# Autodesk Inventor assembly: ASSEMBLY_DUT_Ant_Rotator_REVB
(part 5 of 5)
- Mate:871: LC_3mm_ALU_Alu_Frame_Brace_REVB:1 ↔ DIN 125-1 A A 4,3:26
- Mate:872: LC_3mm_ALU_Alu_Frame_Brace_REVB:1 ↔ DIN 125-1 A A 4,3:26
- Insert:48: DIN 125-1 A A 4,3:25 ↔ DIN 912 - replaced by DIN EN ISO 4762 M4 x 25:1
- Insert:49: DIN 125-1 A A 4,3:26 ↔ DIN 912 - replaced by DIN EN ISO 4762 M4 x 25:2
- Mate:873: LC_3mm_ALU_Alu_Frame_Brace_REVB:1 ↔ DIN 934 - replaced by DIN EN 24032/28673/28674 M4:33
- Mate:874: 3DP_PLA_Alu_Frame_Brace_REVB:1 ↔ DIN 934 - replaced by DIN EN 24032/28673/28674 M4:33
- Mate:875: LC_3mm_ALU_Alu_Frame_Brace_REVB:1 ↔ DIN 934 - replaced by DIN EN 24032/28673/28674 M4:34
- Mate:876: 3DP_PLA_Alu_Frame_Brace_REVB:1 ↔ DIN 934 - replaced by DIN EN 24032/28673/28674 M4:34
- Mate:877: COTS_Fleximo_FB12020_20x20_Alu_Profile_600mm:1 ↔ 3DP_PLA_Folded_Leg_Holder_REVB:1
- Flush:48 (-2.5 mm): COTS_Fleximo_FB12020_20x20_Alu_Profile_600mm:1 ↔ 3DP_PLA_Folded_Leg_Holder_REVB:1
- Flush:49 (80 mm): COTS_Fleximo_FB12020_20x20_Alu_Profile_150mm:1 ↔ 3DP_PLA_Folded_Leg_Holder_REVB:1
- Mate:878: 3DP_PLA_Folded_Leg_Holder_REVB:1 ↔ DIN 912 - replaced by DIN EN ISO 4762 M4 x 16:7
- Mate:879: 3DP_PLA_Folded_Leg_Holder_REVB:1 ↔ DIN 912 - replaced by DIN EN ISO 4762 M4 x 16:7
- Mate:880: 3DP_PLA_Carbon_Rod_Holder_Bottom_REVB:1 ↔ COTS_Fleximo_FB12020_20x20_Alu_Profile_150mm:5
- Flush:50: 3DP_PLA_Carbon_Rod_Holder_Bottom_REVB:1 ↔ COTS_Fleximo_FB12020_20x20_Alu_Profile_150mm:5
- Flush:51: 3DP_PLA_Carbon_Rod_Holder_Bottom_REVB:1 ↔ COTS_Fleximo_FB12020_20x20_Alu_Profile_600mm:3
- Mate:881: 3DP_PLA_Carbon_Rod_Holder_Top_REVB:1 ↔ COTS_Fleximo_FB12020_20x20_Alu_Profile_150mm:6
- Flush:52: 3DP_PLA_Carbon_Rod_Holder_Top_REVB:1 ↔ COTS_Fleximo_FB12020_20x20_Alu_Profile_150mm:6
- Flush:53: 3DP_PLA_Carbon_Rod_Holder_Top_REVB:1 ↔ COTS_Fleximo_FB12020_20x20_Alu_Profile_600mm:3
- Mate:882: 3DP_PLA_Carbon_Rod_Holder_Top_REVB:1 ↔ DIN 125-1 A A 4,3:39
- Mate:883: 3DP_PLA_Carbon_Rod_Holder_Top_REVB:1 ↔ DIN 125-1 A A 4,3:39
- Mate:884: 3DP_PLA_Carbon_Rod_Holder_Top_REVB:1 ↔ DIN 125-1 A A 4,3:40
- Mate:885: 3DP_PLA_Carbon_Rod_Holder_Top_REVB:1 ↔ DIN 125-1 A A 4,3:40
- Mate:886: 3DP_PLA_Carbon_Rod_Holder_Bottom_REVB:1 ↔ DIN 125-1 A A 4,3:41
- Mate:887: 3DP_PLA_Carbon_Rod_Holder_Top_REVB:1 ↔ DIN 125-1 A A 4,3:41
- Mate:888: 3DP_PLA_Carbon_Rod_Holder_Bottom_REVB:1 ↔ DIN 125-1 A A 4,3:42
- Mate:889: 3DP_PLA_Carbon_Rod_Holder_Top_REVB:1 ↔ DIN 125-1 A A 4,3:42
- Insert:50: DIN 912 - replaced by DIN EN ISO 4762 M4 x 10:20 ↔ DIN 125-1 A A 4,3:39
- Insert:51: DIN 912 - replaced by DIN EN ISO 4762 M4 x 10:21 ↔ DIN 125-1 A A 4,3:40
- Insert:52: DIN 912 - replaced by DIN EN ISO 4762 M4 x 10:22 ↔ DIN 125-1 A A 4,3:41
- Insert:53: DIN 912 - replaced by DIN EN ISO 4762 M4 x 10:23 ↔ DIN 125-1 A A 4,3:42
- Mate:890: COTS_Fleximo_FB12020_20x20_Alu_Profile_600mm:1 ↔ 3DP_PLA_Frame_Stiffener_and_Leg_REVB:1
- Flush:54: COTS_Fleximo_FB12020_20x20_Alu_Profile_600mm:1 ↔ 3DP_PLA_Frame_Stiffener_and_Leg_REVB:1
- Flush:55: COTS_Fleximo_FB12020_20x20_Alu_Profile_600mm:1 ↔ 3DP_PLA_Frame_Stiffener_and_Leg_REVB:1
- Mate:891: ISO 7380-1 M6 x 16:1 ↔ 3DP_PLA_Frame_Stiffener_and_Leg_REVB:1
- Mate:892: ISO 7380-1 M6 x 16:1 ↔ 3DP_PLA_Frame_Stiffener_and_Leg_REVB:1
- Mate:893: 3DP_PLA_Frame_Stiffener_and_Leg_REVB:1 ↔ ISO 7380-1 M5 x 8:1
- Mate:894: 3DP_PLA_Frame_Stiffener_and_Leg_REVB:1 ↔ ISO 7380-1 M5 x 8:1
- Mate:895: 3DP_PLA_Frame_Stiffener_and_Leg_REVB:1 ↔ ISO 7380-1 M5 x 8:2
- Mate:896: 3DP_PLA_Frame_Stiffener_and_Leg_REVB:1 ↔ ISO 7380-1 M5 x 8:2
- Mate:897: COTS_Fleximo_FB12020_20x20_Alu_Profile_600mm:1 ↔ 3DP_PLA_Frame_Stiffener_and_Leg_REVB:2
- Flush:56: COTS_Fleximo_FB12020_20x20_Alu_Profile_600mm:1 ↔ 3DP_PLA_Frame_Stiffener_and_Leg_REVB:2
- Flush:57: COTS_Fleximo_FB12020_20x20_Alu_Profile_600mm:1 ↔ 3DP_PLA_Frame_Stiffener_and_Leg_REVB:2
- Mate:898: 3DP_PLA_Frame_Stiffener_and_Leg_REVB:2 ↔ ISO 7380-1 M6 x 16:2
- Mate:899: 3DP_PLA_Frame_Stiffener_and_Leg_REVB:2 ↔ ISO 7380-1 M6 x 16:2
- Mate:900: 3DP_PLA_Frame_Stiffener_and_Leg_REVB:2 ↔ ISO 7380-1 M5 x 8:3
- Mate:901: 3DP_PLA_Frame_Stiffener_and_Leg_REVB:2 ↔ ISO 7380-1 M5 x 8:3
- Mate:902: 3DP_PLA_Frame_Stiffener_and_Leg_REVB:2 ↔ ISO 7380-1 M5 x 8:4
- Mate:903: 3DP_PLA_Frame_Stiffener_and_Leg_REVB:2 ↔ ISO 7380-1 M5 x 8:4
- Mate:904: COTS_Fleximo_FB12020_20x20_Alu_Profile_575mm:1 ↔ 3DP_PLA_Frame_Leg_Leg_REVB:1
- Flush:58: COTS_Fleximo_FB12020_20x20_Alu_Profile_575mm:1 ↔ 3DP_PLA_Frame_Leg_Leg_REVB:1
- Flush:59: 3DP_PLA_Foldable_Leg_Brace_Mount_REVB:1 ↔ 3DP_PLA_Frame_Leg_Leg_REVB:1
- Mate:905: ISO 7380-1 M5 x 8:13 ↔ 3DP_PLA_Frame_Leg_Leg_REVB:1
- Mate:906: ISO 7380-1 M5 x 8:13 ↔ 3DP_PLA_Frame_Leg_Leg_REVB:1
- Mate:907: 3DP_PLA_Frame_Leg_Leg_REVB:1 ↔ ISO 7380-1 M5 x 8:14
- Mate:908: 3DP_PLA_Frame_Leg_Leg_REVB:1 ↔ ISO 7380-1 M5 x 8:14
- Mate:909: 3DP_PLA_Electronics_Box_Bottom_REVB:1 ↔ ASSEMBLY_PCB_SERVO_CONN:1
- Mate:910: 3DP_PLA_Electronics_Box_Bottom_REVB:1 ↔ ASSEMBLY_PCB_SERVO_CONN:1
- Mate:911: 3DP_PLA_Electronics_Box_Bottom_REVB:1 ↔ ASSEMBLY_PCB_SERVO_CONN:1
- Mate:912: 3DP_PLA_Electronics_Box_Bottom_REVB:1 ↔ COTS_MKS_Canable_2_0:1
- Mate:913: 3DP_PLA_Electronics_Box_Bottom_REVB:1 ↔ COTS_MKS_Canable_2_0:1
- Mate:914: 3DP_PLA_Electronics_Box_Bottom_REVB:1 ↔ COTS_MKS_Canable_2_0:1
- Mate:915: 3DP_PLA_Electronics_Box_Bottom_REVB:1 ↔ COTS_Fleximo_FB12020_20x20_Alu_Profile_600mm:2
- Mate:916: 3DP_PLA_Electronics_Box_Bottom_REVB:1 ↔ COTS_Fleximo_FB12020_20x20_Alu_Profile_600mm:2
- Flush:60: 3DP_PLA_Electronics_Box_Bottom_REVB:1 ↔ 3DP_PLA_Folded_Leg_Holder_REVB:3
- Mate:917: 3DP_PLA_Electronics_Box_Bottom_REVB:1 ↔ 3DP_PLA_Electronics_Box_Top_REVB:1
- Flush:61: 3DP_PLA_Electronics_Box_Bottom_REVB:1 ↔ 3DP_PLA_Electronics_Box_Top_REVB:1
- Flush:62: 3DP_PLA_Electronics_Box_Bottom_REVB:1 ↔ 3DP_PLA_Electronics_Box_Top_REVB:1
- Mate:918: ASSEMBLY_PCB_SERVO_CONN:1 ↔ ISO 7380-1 M3 x 6:1
- Mate:919: ASSEMBLY_PCB_SERVO_CONN:1 ↔ ISO 7380-1 M3 x 6:1
- Mate:920: ASSEMBLY_PCB_SERVO_CONN:1 ↔ ISO 7380-1 M3 x 6:2
- Mate:921: ASSEMBLY_PCB_SERVO_CONN:1 ↔ ISO 7380-1 M3 x 6:2
- Mate:922: ASSEMBLY_PCB_SERVO_CONN:1 ↔ ISO 7380-1 M3 x 6:3
- Mate:923: ASSEMBLY_PCB_SERVO_CONN:1 ↔ ISO 7380-1 M3 x 6:3
- Mate:924: ASSEMBLY_PCB_SERVO_CONN:1 ↔ ISO 7380-1 M3 x 6:4
- Mate:925: ASSEMBLY_PCB_SERVO_CONN:1 ↔ ISO 7380-1 M3 x 6:4
- Mate:926: COTS_MKS_Canable_2_0:1 ↔ DIN 912 - replaced by DIN EN ISO 4762 M2 x 6:1
- Mate:927: COTS_MKS_Canable_2_0:1 ↔ DIN 912 - replaced by DIN EN ISO 4762 M2 x 6:1
- Mate:928: COTS_MKS_Canable_2_0:1 ↔ DIN 912 - replaced by DIN EN ISO 4762 M2 x 6:2
- Mate:929: COTS_MKS_Canable_2_0:1 ↔ DIN 912 - replaced by DIN EN ISO 4762 M2 x 6:2
- Mate:930: COTS_MKS_Canable_2_0:1 ↔ DIN 912 - replaced by DIN EN ISO 4762 M2 x 6:3
- Mate:931: COTS_MKS_Canable_2_0:1 ↔ DIN 912 - replaced by DIN EN ISO 4762 M2 x 6:3
- Mate:932: COTS_MKS_Canable_2_0:1 ↔ DIN 912 - replaced by DIN EN ISO 4762 M2 x 6:4
- Mate:933: COTS_MKS_Canable_2_0:1 ↔ DIN 912 - replaced by DIN EN ISO 4762 M2 x 6:4
- Mate:934: 3DP_PLA_Electronics_Box_Bottom_REVB:1 ↔ DIN 912 - replaced by DIN EN ISO 4762 M3 x 30:1
- Mate:935: 3DP_PLA_Electronics_Box_Bottom_REVB:1 ↔ DIN 912 - replaced by DIN EN ISO 4762 M3 x 30:1
- Mate:936: 3DP_PLA_Electronics_Box_Bottom_REVB:1 ↔ DIN 912 - replaced by DIN EN ISO 4762 M3 x 30:2
- Mate:937: 3DP_PLA_Electronics_Box_Bottom_REVB:1 ↔ DIN 912 - replaced by DIN EN ISO 4762 M3 x 30:2
- Mate:938: 3DP_PLA_Electronics_Box_Bottom_REVB:1 ↔ DIN 912 - replaced by DIN EN ISO 4762 M3 x 30:3
- Mate:939: 3DP_PLA_Electronics_Box_Bottom_REVB:1 ↔ DIN 912 - replaced by DIN EN ISO 4762 M3 x 30:3
- Mate:940: 3DP_PLA_Electronics_Box_Bottom_REVB:1 ↔ DIN 912 - replaced by DIN EN ISO 4762 M3 x 30:4
- Mate:941: 3DP_PLA_Electronics_Box_Bottom_REVB:1 ↔ DIN 912 - replaced by DIN EN ISO 4762 M3 x 30:4
- Mate:942: 3DP_PLA_Electronics_Box_Bottom_REVB:1 ↔ DIN 934 - replaced by DIN EN 24032/28673/28674 M3:1
- Mate:943: 3DP_PLA_Electronics_Box_Top_REVB:1 ↔ DIN 934 - replaced by DIN EN 24032/28673/28674 M3:1
- Mate:944: 3DP_PLA_Electronics_Box_Bottom_REVB:1 ↔ DIN 934 - replaced by DIN EN 24032/28673/28674 M3:2
- Mate:945: 3DP_PLA_Electronics_Box_Top_REVB:1 ↔ DIN 934 - replaced by DIN EN 24032/28673/28674 M3:2
- Mate:946: 3DP_PLA_Electronics_Box_Bottom_REVB:1 ↔ DIN 934 - replaced by DIN EN 24032/28673/28674 M3:3
- Mate:947: 3DP_PLA_Electronics_Box_Top_REVB:1 ↔ DIN 934 - replaced by DIN EN 24032/28673/28674 M3:3
- Mate:948: 3DP_PLA_Electronics_Box_Bottom_REVB:1 ↔ DIN 934 - replaced by DIN EN 24032/28673/28674 M3:4
- Mate:949: 3DP_PLA_Electronics_Box_Top_REVB:1 ↔ DIN 934 - replaced by DIN EN 24032/28673/28674 M3:4
- Mate:950: 3DP_PLA_Electronics_Box_Top_REVB:1 ↔ DIN 912 - replaced by DIN EN ISO 4762 M3 x 8:1
- Mate:951: 3DP_PLA_Electronics_Box_Top_REVB:1 ↔ DIN 912 - replaced by DIN EN ISO 4762 M3 x 8:1
- Mate:952: 3DP_PLA_Electronics_Box_Top_REVB:1 ↔ DIN 912 - replaced by DIN EN ISO 4762 M3 x 8:2
- Mate:953: 3DP_PLA_Electronics_Box_Top_REVB:1 ↔ DIN 912 - replaced by DIN EN ISO 4762 M3 x 8:2
- Mate:954: 3DP_PLA_Electronics_Box_Bottom_REVB:1 ↔ DIN 912 - replaced by DIN EN ISO 4762 M3 x 8:3
- Mate:955: 3DP_PLA_Electronics_Box_Bottom_REVB:1 ↔ DIN 912 - replaced by DIN EN ISO 4762 M3 x 8:3
- Mate:956: 3DP_PLA_Electronics_Box_Bottom_REVB:1 ↔ DIN 912 - replaced by DIN EN ISO 4762 M3 x 8:4
- Mate:957: 3DP_PLA_Electronics_Box_Bottom_REVB:1 ↔ DIN 912 - replaced by DIN EN ISO 4762 M3 x 8:4
- Mate:958: COTS_CARBONCENTER_Fiberglass_Tube_27x24x383mm:8 ↔ 3DP_PLA_Antenna_Boom_Dual_Ridged_Horn_3DP_REVB:1
- Flush:63: 3DP_PLA_Antenna_Boom_Fiberglass_Pipe_Clamp:1 ↔ 3DP_PLA_Antenna_Boom_Dual_Ridged_Horn_3DP_REVB:1
- Flush:64: 3DP_PLA_Antenna_Boom_Fiberglass_Pipe_Clamp:1 ↔ 3DP_PLA_Antenna_Boom_Dual_Ridged_Horn_3DP_REVB:1
- Mate:959: COTS_BYTECHLAB_Dual_Ridged_Horn:1 ↔ 3DP_PLA_Antenna_Boom_Dual_Ridged_Horn_3DP_REVB:1
- Mate:960: COTS_BYTECHLAB_Dual_Ridged_Horn:1 ↔ 3DP_PLA_Antenna_Boom_Dual_Ridged_Horn_3DP_REVB:1
- Mate:961: COTS_BYTECHLAB_Dual_Ridged_Horn:1 ↔ 3DP_PLA_Antenna_Boom_Dual_Ridged_Horn_3DP_REVB:1
- Mate:962: COTS_CARBONCENTER_Fiberglass_Tube_27x24x383mm:8 ↔ 3DP_PLA_Antenna_Boom_High_Frequency_Biconical_REVB:1
- Flush:65: 3DP_PLA_Antenna_Boom_Fiberglass_Pipe_Clamp:1 ↔ 3DP_PLA_Antenna_Boom_High_Frequency_Biconical_REVB:1
- Flush:66: 3DP_PLA_Antenna_Boom_Fiberglass_Pipe_Clamp:1 ↔ 3DP_PLA_Antenna_Boom_High_Frequency_Biconical_REVB:1
- Mate:963: 3DP_PLA_Antenna_Boom_High_Frequency_Biconical_REVB:1 ↔ COTS_BYTECHLAB_High_Freq_Biconical:1
- Mate:964: 3DP_PLA_Antenna_Boom_High_Frequency_Biconical_REVB:1 ↔ COTS_BYTECHLAB_High_Freq_Biconical:1
- Flush:67: 3DP_PLA_Antenna_Boom_Fiberglass_Pipe_Clamp:1 ↔ 3DP_PLA_Antenna_Boom_Microstrip_Patch_Array_REVB:1
- Flush:68: 3DP_PLA_Antenna_Boom_Fiberglass_Pipe_Clamp:1 ↔ 3DP_PLA_Antenna_Boom_Microstrip_Patch_Array_REVB:1
- Mate:965: COTS_CARBONCENTER_Fiberglass_Tube_27x24x383mm:8 ↔ 3DP_PLA_Antenna_Boom_Microstrip_Patch_Array_REVB:1
- Mate:966: COTS_BYTECHLAB_Microstrip_Patch_Array:1 ↔ 3DP_PLA_Antenna_Boom_Microstrip_Patch_Array_REVB:1
- Mate:967: COTS_BYTECHLAB_Microstrip_Patch_Array:1 ↔ 3DP_PLA_Antenna_Boom_Microstrip_Patch_Array_REVB:1
- Mate:968: COTS_CARBONCENTER_Fiberglass_Tube_27x24x383mm:8 ↔ 3DP_PLA_Antenna_Boom_2_4GHz_2x2_Phased_Array_REVB:1
- Flush:69: 3DP_PLA_Antenna_Boom_Fiberglass_Pipe_Clamp:1 ↔ 3DP_PLA_Antenna_Boom_2_4GHz_2x2_Phased_Array_REVB:1
- Flush:70: 3DP_PLA_Antenna_Boom_Fiberglass_Pipe_Clamp:1 ↔ 3DP_PLA_Antenna_Boom_2_4GHz_2x2_Phased_Array_REVB:1
- Mate:969: COTS_BYTECHLAB_2_4_GHz_2x2_Phased_Array:1 ↔ 3DP_PLA_Antenna_Boom_2_4GHz_2x2_Phased_Array_REVB:1
- Mate:970: COTS_BYTECHLAB_2_4_GHz_2x2_Phased_Array:1 ↔ 3DP_PLA_Antenna_Boom_2_4GHz_2x2_Phased_Array_REVB:1
- Angle:75 (0 deg): COTS_BYTECHLAB_2_4_GHz_2x2_Phased_Array:1 ↔ 3DP_PLA_Antenna_Boom_2_4GHz_2x2_Phased_Array_REVB:1
- Mate:971: COTS_CARBONCENTER_Fiberglass_Tube_27x24x383mm:8 ↔ 3DP_PLA_Antenna_Boom_Log_Periodic_REVB:1
- Flush:71: 3DP_PLA_Antenna_Boom_Fiberglass_Pipe_Clamp:1 ↔ 3DP_PLA_Antenna_Boom_Log_Periodic_REVB:1
- Flush:72: 3DP_PLA_Antenna_Boom_Fiberglass_Pipe_Clamp:1 ↔ 3DP_PLA_Antenna_Boom_Log_Periodic_REVB:1
- Mate:972: COTS_BYTECHLAB_Log_Periodic:1 ↔ 3DP_PLA_Antenna_Boom_Log_Periodic_REVB:1
- Mate:973: COTS_BYTECHLAB_Log_Periodic:1 ↔ 3DP_PLA_Antenna_Boom_Log_Periodic_REVB:1
- Flush:73 (17.5 mm): COTS_BYTECHLAB_Log_Periodic:1 ↔ 3DP_PLA_Antenna_Boom_Log_Periodic_REVB:1
- Mate:974: 3DP_PLA_Antenna_Boom_Log_Periodic_REVB:1 ↔ 3DP_PLA_Antenna_Boom_Log_Periodic_Clamp_REVB:1
- Mate:975: 3DP_PLA_Antenna_Boom_Log_Periodic_REVB:1 ↔ 3DP_PLA_Antenna_Boom_Log_Periodic_Clamp_REVB:1
- Mate:976: 3DP_PLA_Antenna_Boom_Log_Periodic_REVB:1 ↔ 3DP_PLA_Antenna_Boom_Log_Periodic_Clamp_REVB:1
- Mate:977: COTS_CARBONCENTER_Fiberglass_Tube_27x24x383mm:8 ↔ 3DP_PLA_Antenna_Boom_Antipodal_Vivaldi_REVB:1
- Flush:74: 3DP_PLA_Antenna_Boom_Fiberglass_Pipe_Clamp:1 ↔ 3DP_PLA_Antenna_Boom_Antipodal_Vivaldi_REVB:1
- Flush:75: 3DP_PLA_Antenna_Boom_Fiberglass_Pipe_Clamp:1 ↔ 3DP_PLA_Antenna_Boom_Antipodal_Vivaldi_REVB:1
- Mate:978: COTS_BYTECHLAB_Antipodal_Vivaldi:1 ↔ 3DP_PLA_Antenna_Boom_Antipodal_Vivaldi_REVB:1
- Mate:979: COTS_BYTECHLAB_Antipodal_Vivaldi:1 ↔ 3DP_PLA_Antenna_Boom_Antipodal_Vivaldi_REVB:1
- Mate:980 (2.5 mm): COTS_BYTECHLAB_Antipodal_Vivaldi:1 ↔ 3DP_PLA_Antenna_Boom_Antipodal_Vivaldi_REVB:1
- Mate:981: 3DP_PLA_Antenna_Boom_Antipodal_Vivaldi_REVB:1 ↔ 3DP_PLA_Antenna_Boom_Clamp_Antipodal_Vivaldi_REVB:1
- Mate:982: 3DP_PLA_Antenna_Boom_Antipodal_Vivaldi_REVB:1 ↔ 3DP_PLA_Antenna_Boom_Clamp_Antipodal_Vivaldi_REVB:1
- Mate:983: 3DP_PLA_Antenna_Boom_Antipodal_Vivaldi_REVB:1 ↔ 3DP_PLA_Antenna_Boom_Clamp_Antipodal_Vivaldi_REVB:1
